# Autodesk Inventor assembly: iterasi1
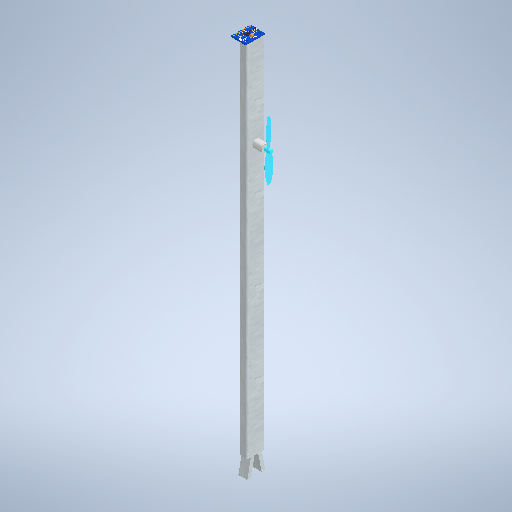
[picture p0: Inventor's stored thumbnail of the model, 512x512]
Saved by Autodesk Inventor 2026.2 (Build 302298010, 298A)
## iProperties
Created: 2026-11-09
Part Number: iterasi1
Document SubType Name: Assembly
Designer: Acer
Author: Acer
## Documents named in this file (5)
- D:\Cool Yeah\Semester 3\Praktikum SKD\Projek-Akhir\3Dmodel\iterasi1.iam
- D:\Cool Yeah\Semester 3\Praktikum SKD\Projek-Akhir\3Dmodel\8520-coreless-brushed-motor-1.snapshot.2\8520 Coreless Brshed motor\8520 Coreless Brshed motor\8520 Coreless Brshed motor.ipt
- D:\Cool Yeah\Semester 3\Praktikum SKD\Projek-Akhir\3Dmodel\MPU6050\MPU6050 Accelerometer\MPU6050 Accelerometer\MPU6050 Accelerometer.ipt
- D:\Cool Yeah\Semester 3\Praktikum SKD\Projek-Akhir\3Dmodel\iterasi1.ipt
- D:\Cool Yeah\Semester 3\Praktikum SKD\Projek-Akhir\3Dmodel\propeller-65-mm-helice-65mm-1.snapshot.5\helice-ccw-65mm\helice-ccw-65mm\helice-ccw-65mm.ipt
## Components (4 placed, 4 different names)
1. iterasi1:1 — Mate:1, Insert:1, Flush:1
2. 8520 Coreless Brshed motor:1 — Insert:1, Mate:2, Mate:3
3. MPU6050 Accelerometer:1 — Mate:1, Flush:1
4. helice-ccw-65mm:2 — Mate:2, Mate:3
## Relationships (5: Mate 3, Insert 1, Flush 1)
- Mate:1: iterasi1:1 ↔ MPU6050 Accelerometer:1
- Insert:1: iterasi1:1 ↔ 8520 Coreless Brshed motor:1
- Flush:1: iterasi1:1 ↔ MPU6050 Accelerometer:1
- Mate:2: 8520 Coreless Brshed motor:1 ↔ helice-ccw-65mm:2
- Mate:3: 8520 Coreless Brshed motor:1 ↔ helice-ccw-65mm:2
